# Autodesk Inventor assembly: robotfish_new_1
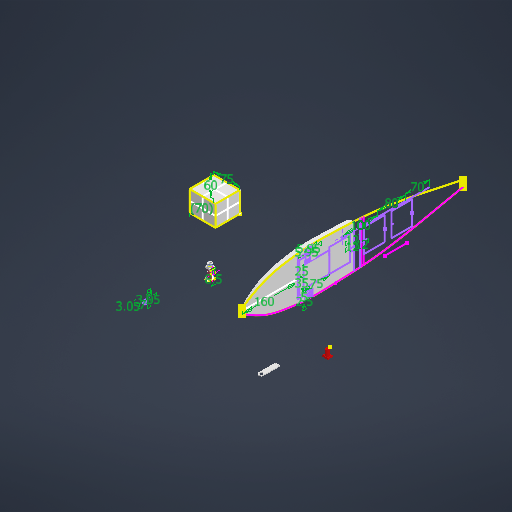
[picture p0: Inventor's stored thumbnail of the model, 512x512]
Saved by Autodesk Inventor 2027 (Build 310192060, 192F)
## iProperties
Created: 2026-08-14
Part Number: robotfish_new_1
Document SubType Name: Assembly
Designer: thita
Author: thita
## Documents named in this file (9)
- D:\Year2\đồ án tốt nghịp\đồ án tốt nghiệp v2\robotfish_new\Workgroups\NotInProject\robotfish_new_1.iam
- D:\Year2\đồ án tốt nghịp\đồ án tốt nghiệp v2\robotfish_new\Workgroups\NotInProject\main_body.ipt
- D:\Year2\đồ án tốt nghịp\đồ án tốt nghiệp v2\robotfish_new\Workgroups\NotInProject\cáthanh tam giác 2.ipt
- D:\Year2\đồ án tốt nghịp\đồ án tốt nghiệp v2\robotfish_new\Workgroups\NotInProject\Part1.ipt
- D:\Year2\đồ án tốt nghịp\đồ án tốt nghiệp v2\robotfish_new\Workgroups\NotInProject\Part2.ipt
- D:\Year2\đồ án tốt nghịp\1\Workgroups\NotInProject\truc_khop_3_MIR.ipt
- D:\Year2\đồ án tốt nghịp\1\Workgroups\NotInProject\Truc_khop_new_2.ipt
- D:\Year2\đồ án tốt nghịp\1\Workgroups\NotInProject\Truc_khop_new_3.ipt
- D:\Year2\đồ án tốt nghịp\new fish\new new new new\Workgroups\NotInProject\Pin 7.8Ah.ipt
## Components (8 placed, 8 different names)
1. main_body:1
2. cáthanh tam giác 2:2
3. Part1:1
4. Part2:1
5. truc_khop_3_MIR:1
6. Truc_khop_new_2:1 — Mate:1, Mate:2, Flush:1
7. Truc_khop_new_3:1 — Mate:1, Mate:2, Flush:1
8. Pin 7.8Ah:3
## Relationships (3: Mate 2, Flush 1)
- Mate:1: Truc_khop_new_2:1 ↔ Truc_khop_new_3:1
- Mate:2: Truc_khop_new_2:1 ↔ Truc_khop_new_3:1
- Flush:1: Truc_khop_new_2:1 ↔ Truc_khop_new_3:1
